(part 1 of 2)
# Autodesk Inventor assembly: PCB_v3.6
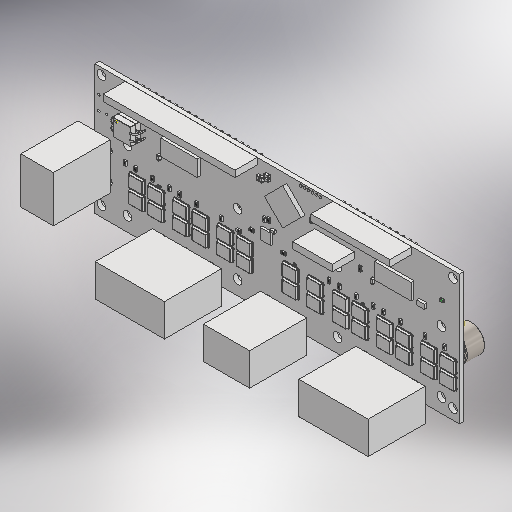
[picture p0: Inventor's stored thumbnail of the model, 512x512]
Saved by Autodesk Inventor 2025.2 (Build 292293000, 293)
## iProperties
Created: 2025-07-11
Part Number: PCB_v3.6
Description: STEP AP242
Document SubType Name: Assembly
Designer: 8326d
Title: 6870d66e9910ab7169fda94c
Sending System: ONSHAPE BY PTC INC, 1.200
Preprocessor: ST-DEVELOPER v20
## Documents named in this file (608)
- C:\Users\8326d\Downloads\PCB_v3.6\PCB_v3.6\PCB_v3.6.iam
- C:\Users\8326d\Downloads\PCB_v3.6\PCB_v3.6\Open CASCADE STEP translator 6.8 1.1.1.ipt
- C:\Users\8326d\Downloads\PCB_v3.6\PCB_v3.6\CAPC3216X175N_-_1206_(3216_metric).ipt
- C:\Users\8326d\Downloads\PCB_v3.6\PCB_v3.6\RES_0603_(1608_metric).ipt
- C:\Users\8326d\Downloads\PCB_v3.6\PCB_v3.6\Extruded.ipt
- C:\Users\8326d\Downloads\PCB_v3.6\PCB_v3.6\Extruded_1.ipt
- C:\Users\8326d\Downloads\PCB_v3.6\PCB_v3.6\Extruded_2.ipt
- C:\Users\8326d\Downloads\PCB_v3.6\PCB_v3.6\CAPC3216X175N_-_1206_(3216_metric)_1.ipt
- C:\Users\8326d\Downloads\PCB_v3.6\PCB_v3.6\RES_0603_(1608_metric)_1.ipt
- C:\Users\8326d\Downloads\PCB_v3.6\PCB_v3.6\RES_0603_(1608_metric)_2.ipt
- C:\Users\8326d\Downloads\PCB_v3.6\PCB_v3.6\RES_0603_(1608_metric)_3.ipt
- C:\Users\8326d\Downloads\PCB_v3.6\PCB_v3.6\RES_0603_(1608_metric)_4.ipt
- C:\Users\8326d\Downloads\PCB_v3.6\PCB_v3.6\Extruded_3.ipt
- C:\Users\8326d\Downloads\PCB_v3.6\PCB_v3.6\Extruded_1_1.ipt
- C:\Users\8326d\Downloads\PCB_v3.6\PCB_v3.6\Extruded_4.ipt
- C:\Users\8326d\Downloads\PCB_v3.6\PCB_v3.6\Extruded_2_1.ipt
- C:\Users\8326d\Downloads\PCB_v3.6\PCB_v3.6\Extruded_3_1.ipt
- C:\Users\8326d\Downloads\PCB_v3.6\PCB_v3.6\Extruded_1_2.ipt
- C:\Users\8326d\Downloads\PCB_v3.6\PCB_v3.6\Extruded_2_2.ipt
- C:\Users\8326d\Downloads\PCB_v3.6\PCB_v3.6\Extruded_3_2.ipt
- C:\Users\8326d\Downloads\PCB_v3.6\PCB_v3.6\Extruded_1_3.ipt
- C:\Users\8326d\Downloads\PCB_v3.6\PCB_v3.6\Extruded_4_1.ipt
- C:\Users\8326d\Downloads\PCB_v3.6\PCB_v3.6\Extruded_5.ipt
- C:\Users\8326d\Downloads\PCB_v3.6\PCB_v3.6\Extruded_2_3.ipt
- C:\Users\8326d\Downloads\PCB_v3.6\PCB_v3.6\Open_CASCADE_STEP_translator_6.8_2.1.ipt
- C:\Users\8326d\Downloads\PCB_v3.6\PCB_v3.6\Open_CASCADE_STEP_translator_6.8_2.2.1.ipt
- C:\Users\8326d\Downloads\PCB_v3.6\PCB_v3.6\Leader.ipt
- C:\Users\8326d\Downloads\PCB_v3.6\PCB_v3.6\Leader_1.ipt
- C:\Users\8326d\Downloads\PCB_v3.6\PCB_v3.6\Leader_2.ipt
- C:\Users\8326d\Downloads\PCB_v3.6\PCB_v3.6\Leader_3.ipt
- C:\Users\8326d\Downloads\PCB_v3.6\PCB_v3.6\Extruded_4_2.ipt
- C:\Users\8326d\Downloads\PCB_v3.6\PCB_v3.6\Extruded_5_1.ipt
- C:\Users\8326d\Downloads\PCB_v3.6\PCB_v3.6\Extruded_2_4.ipt
- C:\Users\8326d\Downloads\PCB_v3.6\PCB_v3.6\Extruded_6.ipt
- C:\Users\8326d\Downloads\PCB_v3.6\PCB_v3.6\Extruded_7.ipt
- C:\Users\8326d\Downloads\PCB_v3.6\PCB_v3.6\Extruded_1_4.ipt
- C:\Users\8326d\Downloads\PCB_v3.6\PCB_v3.6\SOT23-5.ipt
- C:\Users\8326d\Downloads\PCB_v3.6\PCB_v3.6\Extruded_6_1.ipt
- C:\Users\8326d\Downloads\PCB_v3.6\PCB_v3.6\Extruded_7_1.ipt
- C:\Users\8326d\Downloads\PCB_v3.6\PCB_v3.6\Extruded_3_3.ipt
- C:\Users\8326d\Downloads\PCB_v3.6\PCB_v3.6\RES_0402_(1005_metric).ipt
- C:\Users\8326d\Downloads\PCB_v3.6\PCB_v3.6\RES_0402_(1005_metric)_1.ipt
- C:\Users\8326d\Downloads\PCB_v3.6\PCB_v3.6\RES_0402_(1005_metric)_2.ipt
- C:\Users\8326d\Downloads\PCB_v3.6\PCB_v3.6\RES_0603_(1608_metric)_5.ipt
- C:\Users\8326d\Downloads\PCB_v3.6\PCB_v3.6\RES_0603_(1608_metric)_6.ipt
- C:\Users\8326d\Downloads\PCB_v3.6\PCB_v3.6\RES_0603_(1608_metric)_7.ipt
- C:\Users\8326d\Downloads\PCB_v3.6\PCB_v3.6\RES_0603_(1608_metric)_8.ipt
- C:\Users\8326d\Downloads\PCB_v3.6\PCB_v3.6\Extruded_3_4.ipt
- C:\Users\8326d\Downloads\PCB_v3.6\PCB_v3.6\Extruded_6_2.ipt
- C:\Users\8326d\Downloads\PCB_v3.6\PCB_v3.6\Extruded_7_2.ipt
- C:\Users\8326d\Downloads\PCB_v3.6\PCB_v3.6\Extruded_4_3.ipt
- C:\Users\8326d\Downloads\PCB_v3.6\PCB_v3.6\Extruded_8.ipt
- C:\Users\8326d\Downloads\PCB_v3.6\PCB_v3.6\Extruded_9.ipt
- C:\Users\8326d\Downloads\PCB_v3.6\PCB_v3.6\Extruded_4_4.ipt
- C:\Users\8326d\Downloads\PCB_v3.6\PCB_v3.6\Extruded_8_1.ipt
- C:\Users\8326d\Downloads\PCB_v3.6\PCB_v3.6\Extruded_9_1.ipt
- C:\Users\8326d\Downloads\PCB_v3.6\PCB_v3.6\Extruded_5_2.ipt
- C:\Users\8326d\Downloads\PCB_v3.6\PCB_v3.6\Extruded_10.ipt
- C:\Users\8326d\Downloads\PCB_v3.6\PCB_v3.6\Extruded_11.ipt
- C:\Users\8326d\Downloads\PCB_v3.6\PCB_v3.6\RES_0603_(1608_metric)_9.ipt
- C:\Users\8326d\Downloads\PCB_v3.6\PCB_v3.6\RES_0603_(1608_metric)_10.ipt
- C:\Users\8326d\Downloads\PCB_v3.6\PCB_v3.6\Extruded_12.ipt
- C:\Users\8326d\Downloads\PCB_v3.6\PCB_v3.6\Extruded_13.ipt
- C:\Users\8326d\Downloads\PCB_v3.6\PCB_v3.6\Extruded_14.ipt
- C:\Users\8326d\Downloads\PCB_v3.6\PCB_v3.6\Extruded_15.ipt
- C:\Users\8326d\Downloads\PCB_v3.6\PCB_v3.6\Extruded_16.ipt
- C:\Users\8326d\Downloads\PCB_v3.6\PCB_v3.6\SOT223-4.ipt
- C:\Users\8326d\Downloads\PCB_v3.6\PCB_v3.6\RES_0603_(1608_metric)_11.ipt
- C:\Users\8326d\Downloads\PCB_v3.6\PCB_v3.6\RES_0603_(1608_metric)_12.ipt
- C:\Users\8326d\Downloads\PCB_v3.6\PCB_v3.6\RES_0603_(1608_metric)_13.ipt
- C:\Users\8326d\Downloads\PCB_v3.6\PCB_v3.6\RES_0603_(1608_metric)_14.ipt
- C:\Users\8326d\Downloads\PCB_v3.6\PCB_v3.6\Extruded_17.ipt
- C:\Users\8326d\Downloads\PCB_v3.6\PCB_v3.6\Extruded_18.ipt
- C:\Users\8326d\Downloads\PCB_v3.6\PCB_v3.6\Extruded_1_5.ipt
- C:\Users\8326d\Downloads\PCB_v3.6\PCB_v3.6\Extruded_2_5.ipt
- C:\Users\8326d\Downloads\PCB_v3.6\PCB_v3.6\Extruded_1_6.ipt
- C:\Users\8326d\Downloads\PCB_v3.6\PCB_v3.6\Extruded_3_5.ipt
- C:\Users\8326d\Downloads\PCB_v3.6\PCB_v3.6\RES_0603_(1608_metric)_15.ipt
- C:\Users\8326d\Downloads\PCB_v3.6\PCB_v3.6\RES_0603_(1608_metric)_16.ipt
- C:\Users\8326d\Downloads\PCB_v3.6\PCB_v3.6\RES_0603_(1608_metric)_17.ipt
- C:\Users\8326d\Downloads\PCB_v3.6\PCB_v3.6\RES_0603_(1608_metric)_18.ipt
- C:\Users\8326d\Downloads\PCB_v3.6\PCB_v3.6\RES_0603_(1608_metric)_19.ipt
- C:\Users\8326d\Downloads\PCB_v3.6\PCB_v3.6\RES_0603_(1608_metric)_20.ipt
- C:\Users\8326d\Downloads\PCB_v3.6\PCB_v3.6\RES_0603_(1608_metric)_21.ipt
- C:\Users\8326d\Downloads\PCB_v3.6\PCB_v3.6\RES_0603_(1608_metric)_22.ipt
- C:\Users\8326d\Downloads\PCB_v3.6\PCB_v3.6\RES_0603_(1608_metric)_23.ipt
- C:\Users\8326d\Downloads\PCB_v3.6\PCB_v3.6\RES_0603_(1608_metric)_24.ipt
- C:\Users\8326d\Downloads\PCB_v3.6\PCB_v3.6\RES_0603_(1608_metric)_25.ipt
- C:\Users\8326d\Downloads\PCB_v3.6\PCB_v3.6\RES_0603_(1608_metric)_26.ipt
- C:\Users\8326d\Downloads\PCB_v3.6\PCB_v3.6\RES_0603_(1608_metric)_27.ipt
- C:\Users\8326d\Downloads\PCB_v3.6\PCB_v3.6\RES_0603_(1608_metric)_28.ipt
- C:\Users\8326d\Downloads\PCB_v3.6\PCB_v3.6\RES_0603_(1608_metric)_29.ipt
- C:\Users\8326d\Downloads\PCB_v3.6\PCB_v3.6\RES_0603_(1608_metric)_30.ipt
- C:\Users\8326d\Downloads\PCB_v3.6\PCB_v3.6\RES_0603_(1608_metric)_31.ipt
- C:\Users\8326d\Downloads\PCB_v3.6\PCB_v3.6\RES_0603_(1608_metric)_32.ipt
- C:\Users\8326d\Downloads\PCB_v3.6\PCB_v3.6\RES_0603_(1608_metric)_33.ipt
- C:\Users\8326d\Downloads\PCB_v3.6\PCB_v3.6\RES_0603_(1608_metric)_34.ipt
- C:\Users\8326d\Downloads\PCB_v3.6\PCB_v3.6\RES_0603_(1608_metric)_35.ipt
- C:\Users\8326d\Downloads\PCB_v3.6\PCB_v3.6\RES_0603_(1608_metric)_36.ipt
- C:\Users\8326d\Downloads\PCB_v3.6\PCB_v3.6\User_Library-DFN5x6_SO8FL_Extruded.ipt
- C:\Users\8326d\Downloads\PCB_v3.6\PCB_v3.6\User_Library-DFN5x6_SO8FL_Extruded_2.ipt
- C:\Users\8326d\Downloads\PCB_v3.6\PCB_v3.6\User_Library-DFN5x6_SO8FL_Extruded_2_1.ipt
- C:\Users\8326d\Downloads\PCB_v3.6\PCB_v3.6\User_Library-DFN5x6_SO8FL_Extruded_1.ipt
- C:\Users\8326d\Downloads\PCB_v3.6\PCB_v3.6\User_Library-DFN5x6_SO8FL_Cylinder.ipt
- C:\Users\8326d\Downloads\PCB_v3.6\PCB_v3.6\User_Library-DFN5x6_SO8FL_Extruded_3.ipt
- C:\Users\8326d\Downloads\PCB_v3.6\PCB_v3.6\User_Library-DFN5x6_SO8FL_Extruded_4.ipt
- C:\Users\8326d\Downloads\PCB_v3.6\PCB_v3.6\User_Library-DFN5x6_SO8FL_Extruded_5.ipt
- C:\Users\8326d\Downloads\PCB_v3.6\PCB_v3.6\User_Library-DFN5x6_SO8FL_Extruded_5_1.ipt
- C:\Users\8326d\Downloads\PCB_v3.6\PCB_v3.6\User_Library-DFN5x6_SO8FL_Extruded_5_2.ipt
- C:\Users\8326d\Downloads\PCB_v3.6\PCB_v3.6\User_Library-DFN5x6_SO8FL_Extruded_5_3.ipt
- C:\Users\8326d\Downloads\PCB_v3.6\PCB_v3.6\User_Library-DFN5x6_SO8FL_Extruded_6.ipt
- C:\Users\8326d\Downloads\PCB_v3.6\PCB_v3.6\User_Library-DFN5x6_SO8FL_Extruded_2_2.ipt
- C:\Users\8326d\Downloads\PCB_v3.6\PCB_v3.6\User_Library-DFN5x6_SO8FL_Extruded_2_2_1.ipt
- C:\Users\8326d\Downloads\PCB_v3.6\PCB_v3.6\User_Library-DFN5x6_SO8FL_Extruded_2_3.ipt
- C:\Users\8326d\Downloads\PCB_v3.6\PCB_v3.6\User_Library-DFN5x6_SO8FL_Extruded_3_1.ipt
- C:\Users\8326d\Downloads\PCB_v3.6\PCB_v3.6\User_Library-DFN5x6_SO8FL_Cylinder_1.ipt
- C:\Users\8326d\Downloads\PCB_v3.6\PCB_v3.6\User_Library-DFN5x6_SO8FL_Extruded_3_1_1.ipt
- C:\Users\8326d\Downloads\PCB_v3.6\PCB_v3.6\User_Library-DFN5x6_SO8FL_Extruded_4_1.ipt
- C:\Users\8326d\Downloads\PCB_v3.6\PCB_v3.6\User_Library-DFN5x6_SO8FL_Extruded_5_4.ipt
- C:\Users\8326d\Downloads\PCB_v3.6\PCB_v3.6\User_Library-DFN5x6_SO8FL_Extruded_5_5.ipt
- C:\Users\8326d\Downloads\PCB_v3.6\PCB_v3.6\User_Library-DFN5x6_SO8FL_Extruded_5_6.ipt
- C:\Users\8326d\Downloads\PCB_v3.6\PCB_v3.6\User_Library-DFN5x6_SO8FL_Extruded_5_7.ipt
- C:\Users\8326d\Downloads\PCB_v3.6\PCB_v3.6\User_Library-DFN5x6_SO8FL_Extruded_6_1.ipt
- C:\Users\8326d\Downloads\PCB_v3.6\PCB_v3.6\User_Library-DFN5x6_SO8FL_Extruded_4_2.ipt
- C:\Users\8326d\Downloads\PCB_v3.6\PCB_v3.6\User_Library-DFN5x6_SO8FL_Extruded_2_4.ipt
- C:\Users\8326d\Downloads\PCB_v3.6\PCB_v3.6\User_Library-DFN5x6_SO8FL_Extruded_2_5.ipt
- C:\Users\8326d\Downloads\PCB_v3.6\PCB_v3.6\User_Library-DFN5x6_SO8FL_Extruded_5_8.ipt
- C:\Users\8326d\Downloads\PCB_v3.6\PCB_v3.6\User_Library-DFN5x6_SO8FL_Cylinder_2.ipt
- C:\Users\8326d\Downloads\PCB_v3.6\PCB_v3.6\User_Library-DFN5x6_SO8FL_Extruded_3_2.ipt
- C:\Users\8326d\Downloads\PCB_v3.6\PCB_v3.6\User_Library-DFN5x6_SO8FL_Extruded_4_2_1.ipt
- C:\Users\8326d\Downloads\PCB_v3.6\PCB_v3.6\User_Library-DFN5x6_SO8FL_Extruded_5_8_1.ipt
- C:\Users\8326d\Downloads\PCB_v3.6\PCB_v3.6\User_Library-DFN5x6_SO8FL_Extruded_5_9.ipt
- C:\Users\8326d\Downloads\PCB_v3.6\PCB_v3.6\User_Library-DFN5x6_SO8FL_Extruded_5_10.ipt
- C:\Users\8326d\Downloads\PCB_v3.6\PCB_v3.6\User_Library-DFN5x6_SO8FL_Extruded_5_11.ipt
- C:\Users\8326d\Downloads\PCB_v3.6\PCB_v3.6\User_Library-DFN5x6_SO8FL_Extruded_6_2.ipt
- C:\Users\8326d\Downloads\PCB_v3.6\PCB_v3.6\User_Library-DFN5x6_SO8FL_Extruded_6_3.ipt
- C:\Users\8326d\Downloads\PCB_v3.6\PCB_v3.6\User_Library-DFN5x6_SO8FL_Extruded_2_6.ipt
- C:\Users\8326d\Downloads\PCB_v3.6\PCB_v3.6\User_Library-DFN5x6_SO8FL_Extruded_2_7.ipt
- C:\Users\8326d\Downloads\PCB_v3.6\PCB_v3.6\User_Library-DFN5x6_SO8FL_Extruded_7.ipt
- C:\Users\8326d\Downloads\PCB_v3.6\PCB_v3.6\User_Library-DFN5x6_SO8FL_Cylinder_3.ipt
- C:\Users\8326d\Downloads\PCB_v3.6\PCB_v3.6\User_Library-DFN5x6_SO8FL_Extruded_3_3.ipt
- C:\Users\8326d\Downloads\PCB_v3.6\PCB_v3.6\User_Library-DFN5x6_SO8FL_Extruded_4_3.ipt
- C:\Users\8326d\Downloads\PCB_v3.6\PCB_v3.6\User_Library-DFN5x6_SO8FL_Extruded_5_12.ipt
- C:\Users\8326d\Downloads\PCB_v3.6\PCB_v3.6\User_Library-DFN5x6_SO8FL_Extruded_5_13.ipt
- C:\Users\8326d\Downloads\PCB_v3.6\PCB_v3.6\User_Library-DFN5x6_SO8FL_Extruded_5_14.ipt
- C:\Users\8326d\Downloads\PCB_v3.6\PCB_v3.6\User_Library-DFN5x6_SO8FL_Extruded_5_15.ipt
- C:\Users\8326d\Downloads\PCB_v3.6\PCB_v3.6\User_Library-DFN5x6_SO8FL_Extruded_6_3_1.ipt
- C:\Users\8326d\Downloads\PCB_v3.6\PCB_v3.6\User_Library-DFN5x6_SO8FL_Extruded_8.ipt
- C:\Users\8326d\Downloads\PCB_v3.6\PCB_v3.6\User_Library-DFN5x6_SO8FL_Extruded_2_8.ipt
- C:\Users\8326d\Downloads\PCB_v3.6\PCB_v3.6\User_Library-DFN5x6_SO8FL_Extruded_2_9.ipt
- C:\Users\8326d\Downloads\PCB_v3.6\PCB_v3.6\User_Library-DFN5x6_SO8FL_Extruded_9.ipt
- C:\Users\8326d\Downloads\PCB_v3.6\PCB_v3.6\User_Library-DFN5x6_SO8FL_Cylinder_4.ipt
- C:\Users\8326d\Downloads\PCB_v3.6\PCB_v3.6\User_Library-DFN5x6_SO8FL_Extruded_3_4.ipt
- C:\Users\8326d\Downloads\PCB_v3.6\PCB_v3.6\User_Library-DFN5x6_SO8FL_Extruded_4_4.ipt
- C:\Users\8326d\Downloads\PCB_v3.6\PCB_v3.6\User_Library-DFN5x6_SO8FL_Extruded_5_16.ipt
- C:\Users\8326d\Downloads\PCB_v3.6\PCB_v3.6\User_Library-DFN5x6_SO8FL_Extruded_5_17.ipt
- C:\Users\8326d\Downloads\PCB_v3.6\PCB_v3.6\User_Library-DFN5x6_SO8FL_Extruded_5_18.ipt
- C:\Users\8326d\Downloads\PCB_v3.6\PCB_v3.6\User_Library-DFN5x6_SO8FL_Extruded_5_19.ipt
- C:\Users\8326d\Downloads\PCB_v3.6\PCB_v3.6\User_Library-DFN5x6_SO8FL_Extruded_6_4.ipt
- C:\Users\8326d\Downloads\PCB_v3.6\PCB_v3.6\User_Library-DFN5x6_SO8FL_Extruded_10.ipt
- C:\Users\8326d\Downloads\PCB_v3.6\PCB_v3.6\User_Library-DFN5x6_SO8FL_Extruded_2_10.ipt
- C:\Users\8326d\Downloads\PCB_v3.6\PCB_v3.6\User_Library-DFN5x6_SO8FL_Extruded_2_11.ipt
- C:\Users\8326d\Downloads\PCB_v3.6\PCB_v3.6\User_Library-DFN5x6_SO8FL_Extruded_11.ipt
- C:\Users\8326d\Downloads\PCB_v3.6\PCB_v3.6\User_Library-DFN5x6_SO8FL_Cylinder_5.ipt
- C:\Users\8326d\Downloads\PCB_v3.6\PCB_v3.6\User_Library-DFN5x6_SO8FL_Extruded_3_5.ipt
- C:\Users\8326d\Downloads\PCB_v3.6\PCB_v3.6\User_Library-DFN5x6_SO8FL_Extruded_4_5.ipt
- C:\Users\8326d\Downloads\PCB_v3.6\PCB_v3.6\User_Library-DFN5x6_SO8FL_Extruded_5_20.ipt
- C:\Users\8326d\Downloads\PCB_v3.6\PCB_v3.6\User_Library-DFN5x6_SO8FL_Extruded_5_21.ipt
- C:\Users\8326d\Downloads\PCB_v3.6\PCB_v3.6\User_Library-DFN5x6_SO8FL_Extruded_5_22.ipt
- C:\Users\8326d\Downloads\PCB_v3.6\PCB_v3.6\User_Library-DFN5x6_SO8FL_Extruded_5_23.ipt
- C:\Users\8326d\Downloads\PCB_v3.6\PCB_v3.6\User_Library-DFN5x6_SO8FL_Extruded_6_5.ipt
- C:\Users\8326d\Downloads\PCB_v3.6\PCB_v3.6\User_Library-DFN5x6_SO8FL_Extruded_12.ipt
- C:\Users\8326d\Downloads\PCB_v3.6\PCB_v3.6\User_Library-DFN5x6_SO8FL_Extruded_2_12.ipt
- C:\Users\8326d\Downloads\PCB_v3.6\PCB_v3.6\User_Library-DFN5x6_SO8FL_Extruded_2_13.ipt
- C:\Users\8326d\Downloads\PCB_v3.6\PCB_v3.6\User_Library-DFN5x6_SO8FL_Extruded_13.ipt
- C:\Users\8326d\Downloads\PCB_v3.6\PCB_v3.6\User_Library-DFN5x6_SO8FL_Cylinder_6.ipt
- C:\Users\8326d\Downloads\PCB_v3.6\PCB_v3.6\User_Library-DFN5x6_SO8FL_Extruded_3_6.ipt
- C:\Users\8326d\Downloads\PCB_v3.6\PCB_v3.6\User_Library-DFN5x6_SO8FL_Extruded_4_6.ipt
- C:\Users\8326d\Downloads\PCB_v3.6\PCB_v3.6\User_Library-DFN5x6_SO8FL_Extruded_5_24.ipt
- C:\Users\8326d\Downloads\PCB_v3.6\PCB_v3.6\User_Library-DFN5x6_SO8FL_Extruded_5_25.ipt
- C:\Users\8326d\Downloads\PCB_v3.6\PCB_v3.6\User_Library-DFN5x6_SO8FL_Extruded_5_26.ipt
- C:\Users\8326d\Downloads\PCB_v3.6\PCB_v3.6\User_Library-DFN5x6_SO8FL_Extruded_5_27.ipt
- C:\Users\8326d\Downloads\PCB_v3.6\PCB_v3.6\User_Library-DFN5x6_SO8FL_Extruded_6_6.ipt
- C:\Users\8326d\Downloads\PCB_v3.6\PCB_v3.6\User_Library-DFN5x6_SO8FL_Extruded_14.ipt
- C:\Users\8326d\Downloads\PCB_v3.6\PCB_v3.6\User_Library-DFN5x6_SO8FL_Extruded_2_14.ipt
- C:\Users\8326d\Downloads\PCB_v3.6\PCB_v3.6\User_Library-DFN5x6_SO8FL_Extruded_2_15.ipt
- C:\Users\8326d\Downloads\PCB_v3.6\PCB_v3.6\User_Library-DFN5x6_SO8FL_Extruded_15.ipt
- C:\Users\8326d\Downloads\PCB_v3.6\PCB_v3.6\User_Library-DFN5x6_SO8FL_Cylinder_7.ipt
- C:\Users\8326d\Downloads\PCB_v3.6\PCB_v3.6\User_Library-DFN5x6_SO8FL_Extruded_3_7.ipt
- C:\Users\8326d\Downloads\PCB_v3.6\PCB_v3.6\User_Library-DFN5x6_SO8FL_Extruded_4_7.ipt
- C:\Users\8326d\Downloads\PCB_v3.6\PCB_v3.6\User_Library-DFN5x6_SO8FL_Extruded_5_28.ipt
- C:\Users\8326d\Downloads\PCB_v3.6\PCB_v3.6\User_Library-DFN5x6_SO8FL_Extruded_5_29.ipt
- C:\Users\8326d\Downloads\PCB_v3.6\PCB_v3.6\User_Library-DFN5x6_SO8FL_Extruded_5_30.ipt
- C:\Users\8326d\Downloads\PCB_v3.6\PCB_v3.6\User_Library-DFN5x6_SO8FL_Extruded_5_31.ipt
- C:\Users\8326d\Downloads\PCB_v3.6\PCB_v3.6\User_Library-DFN5x6_SO8FL_Extruded_6_7.ipt
- C:\Users\8326d\Downloads\PCB_v3.6\PCB_v3.6\User_Library-DFN5x6_SO8FL_Extruded_16.ipt
- C:\Users\8326d\Downloads\PCB_v3.6\PCB_v3.6\User_Library-DFN5x6_SO8FL_Extruded_2_16.ipt
- C:\Users\8326d\Downloads\PCB_v3.6\PCB_v3.6\User_Library-DFN5x6_SO8FL_Extruded_2_17.ipt
- C:\Users\8326d\Downloads\PCB_v3.6\PCB_v3.6\User_Library-DFN5x6_SO8FL_Extruded_17.ipt
- C:\Users\8326d\Downloads\PCB_v3.6\PCB_v3.6\User_Library-DFN5x6_SO8FL_Cylinder_8.ipt
- C:\Users\8326d\Downloads\PCB_v3.6\PCB_v3.6\User_Library-DFN5x6_SO8FL_Extruded_3_8.ipt
- C:\Users\8326d\Downloads\PCB_v3.6\PCB_v3.6\User_Library-DFN5x6_SO8FL_Extruded_4_8.ipt
- C:\Users\8326d\Downloads\PCB_v3.6\PCB_v3.6\User_Library-DFN5x6_SO8FL_Extruded_5_32.ipt
- C:\Users\8326d\Downloads\PCB_v3.6\PCB_v3.6\User_Library-DFN5x6_SO8FL_Extruded_5_33.ipt
- C:\Users\8326d\Downloads\PCB_v3.6\PCB_v3.6\User_Library-DFN5x6_SO8FL_Extruded_5_34.ipt
- C:\Users\8326d\Downloads\PCB_v3.6\PCB_v3.6\User_Library-DFN5x6_SO8FL_Extruded_5_35.ipt
- C:\Users\8326d\Downloads\PCB_v3.6\PCB_v3.6\User_Library-DFN5x6_SO8FL_Extruded_6_8.ipt
- C:\Users\8326d\Downloads\PCB_v3.6\PCB_v3.6\User_Library-DFN5x6_SO8FL_Extruded_18.ipt
- C:\Users\8326d\Downloads\PCB_v3.6\PCB_v3.6\User_Library-DFN5x6_SO8FL_Extruded_2_18.ipt
- C:\Users\8326d\Downloads\PCB_v3.6\PCB_v3.6\User_Library-DFN5x6_SO8FL_Extruded_2_19.ipt
- C:\Users\8326d\Downloads\PCB_v3.6\PCB_v3.6\User_Library-DFN5x6_SO8FL_Extruded_19.ipt
- C:\Users\8326d\Downloads\PCB_v3.6\PCB_v3.6\User_Library-DFN5x6_SO8FL_Cylinder_9.ipt
- C:\Users\8326d\Downloads\PCB_v3.6\PCB_v3.6\User_Library-DFN5x6_SO8FL_Extruded_3_9.ipt
- C:\Users\8326d\Downloads\PCB_v3.6\PCB_v3.6\User_Library-DFN5x6_SO8FL_Extruded_4_9.ipt
- C:\Users\8326d\Downloads\PCB_v3.6\PCB_v3.6\User_Library-DFN5x6_SO8FL_Extruded_5_36.ipt
- C:\Users\8326d\Downloads\PCB_v3.6\PCB_v3.6\User_Library-DFN5x6_SO8FL_Extruded_5_37.ipt
- C:\Users\8326d\Downloads\PCB_v3.6\PCB_v3.6\User_Library-DFN5x6_SO8FL_Extruded_5_38.ipt
- C:\Users\8326d\Downloads\PCB_v3.6\PCB_v3.6\User_Library-DFN5x6_SO8FL_Extruded_5_39.ipt
- C:\Users\8326d\Downloads\PCB_v3.6\PCB_v3.6\User_Library-DFN5x6_SO8FL_Extruded_6_9.ipt
- C:\Users\8326d\Downloads\PCB_v3.6\PCB_v3.6\User_Library-DFN5x6_SO8FL_Extruded_20.ipt
- C:\Users\8326d\Downloads\PCB_v3.6\PCB_v3.6\User_Library-DFN5x6_SO8FL_Extruded_2_20.ipt
- C:\Users\8326d\Downloads\PCB_v3.6\PCB_v3.6\User_Library-DFN5x6_SO8FL_Extruded_2_21.ipt
- C:\Users\8326d\Downloads\PCB_v3.6\PCB_v3.6\User_Library-DFN5x6_SO8FL_Extruded_21.ipt
- C:\Users\8326d\Downloads\PCB_v3.6\PCB_v3.6\User_Library-DFN5x6_SO8FL_Cylinder_10.ipt
- C:\Users\8326d\Downloads\PCB_v3.6\PCB_v3.6\User_Library-DFN5x6_SO8FL_Extruded_3_10.ipt
- C:\Users\8326d\Downloads\PCB_v3.6\PCB_v3.6\User_Library-DFN5x6_SO8FL_Extruded_4_10.ipt
- C:\Users\8326d\Downloads\PCB_v3.6\PCB_v3.6\User_Library-DFN5x6_SO8FL_Extruded_5_40.ipt
- C:\Users\8326d\Downloads\PCB_v3.6\PCB_v3.6\User_Library-DFN5x6_SO8FL_Extruded_5_41.ipt
- C:\Users\8326d\Downloads\PCB_v3.6\PCB_v3.6\User_Library-DFN5x6_SO8FL_Extruded_5_42.ipt
- C:\Users\8326d\Downloads\PCB_v3.6\PCB_v3.6\User_Library-DFN5x6_SO8FL_Extruded_5_43.ipt
- C:\Users\8326d\Downloads\PCB_v3.6\PCB_v3.6\User_Library-DFN5x6_SO8FL_Extruded_6_10.ipt
- C:\Users\8326d\Downloads\PCB_v3.6\PCB_v3.6\User_Library-DFN5x6_SO8FL_Extruded_22.ipt
- C:\Users\8326d\Downloads\PCB_v3.6\PCB_v3.6\User_Library-DFN5x6_SO8FL_Extruded_2_22.ipt
- C:\Users\8326d\Downloads\PCB_v3.6\PCB_v3.6\User_Library-DFN5x6_SO8FL_Extruded_2_23.ipt
- C:\Users\8326d\Downloads\PCB_v3.6\PCB_v3.6\User_Library-DFN5x6_SO8FL_Extruded_23.ipt
- C:\Users\8326d\Downloads\PCB_v3.6\PCB_v3.6\User_Library-DFN5x6_SO8FL_Cylinder_11.ipt
- C:\Users\8326d\Downloads\PCB_v3.6\PCB_v3.6\User_Library-DFN5x6_SO8FL_Extruded_3_11.ipt
- C:\Users\8326d\Downloads\PCB_v3.6\PCB_v3.6\User_Library-DFN5x6_SO8FL_Extruded_4_11.ipt
- C:\Users\8326d\Downloads\PCB_v3.6\PCB_v3.6\User_Library-DFN5x6_SO8FL_Extruded_5_44.ipt
- C:\Users\8326d\Downloads\PCB_v3.6\PCB_v3.6\User_Library-DFN5x6_SO8FL_Extruded_5_45.ipt
- C:\Users\8326d\Downloads\PCB_v3.6\PCB_v3.6\User_Library-DFN5x6_SO8FL_Extruded_5_46.ipt
- C:\Users\8326d\Downloads\PCB_v3.6\PCB_v3.6\User_Library-DFN5x6_SO8FL_Extruded_5_47.ipt
- C:\Users\8326d\Downloads\PCB_v3.6\PCB_v3.6\User_Library-DFN5x6_SO8FL_Extruded_6_11.ipt
- C:\Users\8326d\Downloads\PCB_v3.6\PCB_v3.6\User_Library-DFN5x6_SO8FL_Extruded_24.ipt
- C:\Users\8326d\Downloads\PCB_v3.6\PCB_v3.6\User_Library-DFN5x6_SO8FL_Extruded_2_24.ipt
- C:\Users\8326d\Downloads\PCB_v3.6\PCB_v3.6\User_Library-DFN5x6_SO8FL_Extruded_2_25.ipt
- C:\Users\8326d\Downloads\PCB_v3.6\PCB_v3.6\User_Library-DFN5x6_SO8FL_Extruded_25.ipt
- C:\Users\8326d\Downloads\PCB_v3.6\PCB_v3.6\User_Library-DFN5x6_SO8FL_Cylinder_12.ipt
- C:\Users\8326d\Downloads\PCB_v3.6\PCB_v3.6\User_Library-DFN5x6_SO8FL_Extruded_3_12.ipt
- C:\Users\8326d\Downloads\PCB_v3.6\PCB_v3.6\User_Library-DFN5x6_SO8FL_Extruded_4_12.ipt
- C:\Users\8326d\Downloads\PCB_v3.6\PCB_v3.6\User_Library-DFN5x6_SO8FL_Extruded_5_48.ipt
- C:\Users\8326d\Downloads\PCB_v3.6\PCB_v3.6\User_Library-DFN5x6_SO8FL_Extruded_5_49.ipt
- C:\Users\8326d\Downloads\PCB_v3.6\PCB_v3.6\User_Library-DFN5x6_SO8FL_Extruded_5_50.ipt
- C:\Users\8326d\Downloads\PCB_v3.6\PCB_v3.6\User_Library-DFN5x6_SO8FL_Extruded_5_51.ipt
- C:\Users\8326d\Downloads\PCB_v3.6\PCB_v3.6\User_Library-DFN5x6_SO8FL_Extruded_6_12.ipt
- C:\Users\8326d\Downloads\PCB_v3.6\PCB_v3.6\User_Library-DFN5x6_SO8FL_Extruded_26.ipt
- C:\Users\8326d\Downloads\PCB_v3.6\PCB_v3.6\User_Library-DFN5x6_SO8FL_Extruded_2_26.ipt
- C:\Users\8326d\Downloads\PCB_v3.6\PCB_v3.6\User_Library-DFN5x6_SO8FL_Extruded_2_27.ipt
- C:\Users\8326d\Downloads\PCB_v3.6\PCB_v3.6\User_Library-DFN5x6_SO8FL_Extruded_27.ipt
- C:\Users\8326d\Downloads\PCB_v3.6\PCB_v3.6\User_Library-DFN5x6_SO8FL_Cylinder_13.ipt
- C:\Users\8326d\Downloads\PCB_v3.6\PCB_v3.6\User_Library-DFN5x6_SO8FL_Extruded_3_13.ipt
- C:\Users\8326d\Downloads\PCB_v3.6\PCB_v3.6\User_Library-DFN5x6_SO8FL_Extruded_4_13.ipt
- C:\Users\8326d\Downloads\PCB_v3.6\PCB_v3.6\User_Library-DFN5x6_SO8FL_Extruded_5_52.ipt
- C:\Users\8326d\Downloads\PCB_v3.6\PCB_v3.6\User_Library-DFN5x6_SO8FL_Extruded_5_53.ipt
- C:\Users\8326d\Downloads\PCB_v3.6\PCB_v3.6\User_Library-DFN5x6_SO8FL_Extruded_5_54.ipt
- C:\Users\8326d\Downloads\PCB_v3.6\PCB_v3.6\User_Library-DFN5x6_SO8FL_Extruded_5_55.ipt
- C:\Users\8326d\Downloads\PCB_v3.6\PCB_v3.6\User_Library-DFN5x6_SO8FL_Extruded_6_13.ipt
- C:\Users\8326d\Downloads\PCB_v3.6\PCB_v3.6\User_Library-DFN5x6_SO8FL_Extruded_28.ipt
- C:\Users\8326d\Downloads\PCB_v3.6\PCB_v3.6\User_Library-DFN5x6_SO8FL_Extruded_2_28.ipt
- C:\Users\8326d\Downloads\PCB_v3.6\PCB_v3.6\User_Library-DFN5x6_SO8FL_Extruded_2_29.ipt
- C:\Users\8326d\Downloads\PCB_v3.6\PCB_v3.6\User_Library-DFN5x6_SO8FL_Extruded_29.ipt
- C:\Users\8326d\Downloads\PCB_v3.6\PCB_v3.6\User_Library-DFN5x6_SO8FL_Cylinder_14.ipt
- C:\Users\8326d\Downloads\PCB_v3.6\PCB_v3.6\User_Library-DFN5x6_SO8FL_Extruded_3_14.ipt
- C:\Users\8326d\Downloads\PCB_v3.6\PCB_v3.6\User_Library-DFN5x6_SO8FL_Extruded_4_14.ipt
- C:\Users\8326d\Downloads\PCB_v3.6\PCB_v3.6\User_Library-DFN5x6_SO8FL_Extruded_5_56.ipt
- C:\Users\8326d\Downloads\PCB_v3.6\PCB_v3.6\User_Library-DFN5x6_SO8FL_Extruded_5_57.ipt
- C:\Users\8326d\Downloads\PCB_v3.6\PCB_v3.6\User_Library-DFN5x6_SO8FL_Extruded_5_58.ipt
- C:\Users\8326d\Downloads\PCB_v3.6\PCB_v3.6\User_Library-DFN5x6_SO8FL_Extruded_5_59.ipt
- C:\Users\8326d\Downloads\PCB_v3.6\PCB_v3.6\User_Library-DFN5x6_SO8FL_Extruded_6_14.ipt
- C:\Users\8326d\Downloads\PCB_v3.6\PCB_v3.6\User_Library-DFN5x6_SO8FL_Extruded_30.ipt
- C:\Users\8326d\Downloads\PCB_v3.6\PCB_v3.6\User_Library-DFN5x6_SO8FL_Extruded_2_30.ipt
- C:\Users\8326d\Downloads\PCB_v3.6\PCB_v3.6\User_Library-DFN5x6_SO8FL_Extruded_2_31.ipt
- C:\Users\8326d\Downloads\PCB_v3.6\PCB_v3.6\User_Library-DFN5x6_SO8FL_Extruded_31.ipt
- C:\Users\8326d\Downloads\PCB_v3.6\PCB_v3.6\User_Library-DFN5x6_SO8FL_Cylinder_15.ipt
- C:\Users\8326d\Downloads\PCB_v3.6\PCB_v3.6\User_Library-DFN5x6_SO8FL_Extruded_3_15.ipt
- C:\Users\8326d\Downloads\PCB_v3.6\PCB_v3.6\User_Library-DFN5x6_SO8FL_Extruded_4_15.ipt
- C:\Users\8326d\Downloads\PCB_v3.6\PCB_v3.6\User_Library-DFN5x6_SO8FL_Extruded_5_60.ipt
- C:\Users\8326d\Downloads\PCB_v3.6\PCB_v3.6\User_Library-DFN5x6_SO8FL_Extruded_5_61.ipt
- C:\Users\8326d\Downloads\PCB_v3.6\PCB_v3.6\User_Library-DFN5x6_SO8FL_Extruded_5_62.ipt
- C:\Users\8326d\Downloads\PCB_v3.6\PCB_v3.6\User_Library-DFN5x6_SO8FL_Extruded_5_63.ipt
- C:\Users\8326d\Downloads\PCB_v3.6\PCB_v3.6\User_Library-DFN5x6_SO8FL_Extruded_6_15.ipt
- C:\Users\8326d\Downloads\PCB_v3.6\PCB_v3.6\Extruded_19.ipt
- C:\Users\8326d\Downloads\PCB_v3.6\PCB_v3.6\Extruded_20.ipt
- C:\Users\8326d\Downloads\PCB_v3.6\PCB_v3.6\Extruded_1_7.ipt
- C:\Users\8326d\Downloads\PCB_v3.6\PCB_v3.6\Extruded_21.ipt
- C:\Users\8326d\Downloads\PCB_v3.6\PCB_v3.6\Extruded_1_8.ipt
- C:\Users\8326d\Downloads\PCB_v3.6\PCB_v3.6\Extruded_5_3.ipt
- C:\Users\8326d\Downloads\PCB_v3.6\PCB_v3.6\Extruded_10_1.ipt
- C:\Users\8326d\Downloads\PCB_v3.6\PCB_v3.6\Extruded_11_1.ipt
- C:\Users\8326d\Downloads\PCB_v3.6\PCB_v3.6\Extruded_6_3.ipt
- C:\Users\8326d\Downloads\PCB_v3.6\PCB_v3.6\Extruded_12_1.ipt
- C:\Users\8326d\Downloads\PCB_v3.6\PCB_v3.6\Extruded_13_1.ipt
- C:\Users\8326d\Downloads\PCB_v3.6\PCB_v3.6\Extruded_6_4.ipt
- C:\Users\8326d\Downloads\PCB_v3.6\PCB_v3.6\Extruded_12_2.ipt
- C:\Users\8326d\Downloads\PCB_v3.6\PCB_v3.6\Extruded_13_2.ipt
- C:\Users\8326d\Downloads\PCB_v3.6\PCB_v3.6\Extruded_7_3.ipt
- C:\Users\8326d\Downloads\PCB_v3.6\PCB_v3.6\Extruded_14_1.ipt
- C:\Users\8326d\Downloads\PCB_v3.6\PCB_v3.6\Extruded_15_1.ipt
- C:\Users\8326d\Downloads\PCB_v3.6\PCB_v3.6\Extruded_8_2.ipt
- C:\Users\8326d\Downloads\PCB_v3.6\PCB_v3.6\Extruded_16_1.ipt
- C:\Users\8326d\Downloads\PCB_v3.6\PCB_v3.6\Extruded_17_1.ipt
- C:\Users\8326d\Downloads\PCB_v3.6\PCB_v3.6\CAPC3216X175N_-_1206_(3216_metric)_2.ipt
- C:\Users\8326d\Downloads\PCB_v3.6\PCB_v3.6\Extruded_9_2.ipt
- C:\Users\8326d\Downloads\PCB_v3.6\PCB_v3.6\Extruded_18_1.ipt
- C:\Users\8326d\Downloads\PCB_v3.6\PCB_v3.6\Extruded_19_1.ipt
- C:\Users\8326d\Downloads\PCB_v3.6\PCB_v3.6\Extruded_7_4.ipt
- C:\Users\8326d\Downloads\PCB_v3.6\PCB_v3.6\Extruded_14_2.ipt
- C:\Users\8326d\Downloads\PCB_v3.6\PCB_v3.6\Extruded_15_2.ipt
- C:\Users\8326d\Downloads\PCB_v3.6\PCB_v3.6\Extruded_8_3.ipt
- C:\Users\8326d\Downloads\PCB_v3.6\PCB_v3.6\Extruded_16_2.ipt
- C:\Users\8326d\Downloads\PCB_v3.6\PCB_v3.6\Extruded_17_2.ipt
- C:\Users\8326d\Downloads\PCB_v3.6\PCB_v3.6\Extruded_9_3.ipt
- C:\Users\8326d\Downloads\PCB_v3.6\PCB_v3.6\Extruded_18_2.ipt
- C:\Users\8326d\Downloads\PCB_v3.6\PCB_v3.6\Extruded_19_2.ipt
- C:\Users\8326d\Downloads\PCB_v3.6\PCB_v3.6\Extruded_10_2.ipt
- C:\Users\8326d\Downloads\PCB_v3.6\PCB_v3.6\Extruded_20_1.ipt
- C:\Users\8326d\Downloads\PCB_v3.6\PCB_v3.6\Extruded_21_1.ipt
- C:\Users\8326d\Downloads\PCB_v3.6\PCB_v3.6\Extruded_10_3.ipt
- C:\Users\8326d\Downloads\PCB_v3.6\PCB_v3.6\Extruded_20_2.ipt
- C:\Users\8326d\Downloads\PCB_v3.6\PCB_v3.6\Extruded_21_2.ipt
- C:\Users\8326d\Downloads\PCB_v3.6\PCB_v3.6\Extruded_11_2.ipt
- C:\Users\8326d\Downloads\PCB_v3.6\PCB_v3.6\Extruded_22.ipt
- C:\Users\8326d\Downloads\PCB_v3.6\PCB_v3.6\Extruded_23.ipt
- C:\Users\8326d\Downloads\PCB_v3.6\PCB_v3.6\Extruded_12_3.ipt
- C:\Users\8326d\Downloads\PCB_v3.6\PCB_v3.6\Extruded_24.ipt
- C:\Users\8326d\Downloads\PCB_v3.6\PCB_v3.6\Extruded_25.ipt
- C:\Users\8326d\Downloads\PCB_v3.6\PCB_v3.6\Extruded_26.ipt
- C:\Users\8326d\Downloads\PCB_v3.6\PCB_v3.6\Extruded_27.ipt
- C:\Users\8326d\Downloads\PCB_v3.6\PCB_v3.6\Extruded_1_9.ipt
- C:\Users\8326d\Downloads\PCB_v3.6\PCB_v3.6\Extruded_13_3.ipt
- C:\Users\8326d\Downloads\PCB_v3.6\PCB_v3.6\Extruded_26_1.ipt
- C:\Users\8326d\Downloads\PCB_v3.6\PCB_v3.6\Extruded_27_1.ipt
- C:\Users\8326d\Downloads\PCB_v3.6\PCB_v3.6\Extruded_14_3.ipt
- C:\Users\8326d\Downloads\PCB_v3.6\PCB_v3.6\Extruded_28.ipt
- C:\Users\8326d\Downloads\PCB_v3.6\PCB_v3.6\Extruded_29.ipt
- C:\Users\8326d\Downloads\PCB_v3.6\PCB_v3.6\Extruded_15_3.ipt
- C:\Users\8326d\Downloads\PCB_v3.6\PCB_v3.6\Extruded_30.ipt
- C:\Users\8326d\Downloads\PCB_v3.6\PCB_v3.6\Extruded_31.ipt
- C:\Users\8326d\Downloads\PCB_v3.6\PCB_v3.6\Extruded_16_3.ipt
- C:\Users\8326d\Downloads\PCB_v3.6\PCB_v3.6\Extruded_32.ipt
- C:\Users\8326d\Downloads\PCB_v3.6\PCB_v3.6\Extruded_33.ipt
- C:\Users\8326d\Downloads\PCB_v3.6\PCB_v3.6\Extruded_11_3.ipt
- C:\Users\8326d\Downloads\PCB_v3.6\PCB_v3.6\Extruded_22_1.ipt
- C:\Users\8326d\Downloads\PCB_v3.6\PCB_v3.6\Extruded_23_1.ipt
- C:\Users\8326d\Downloads\PCB_v3.6\PCB_v3.6\Extruded_17_3.ipt
- C:\Users\8326d\Downloads\PCB_v3.6\PCB_v3.6\Extruded_34.ipt
- C:\Users\8326d\Downloads\PCB_v3.6\PCB_v3.6\Extruded_35.ipt
- C:\Users\8326d\Downloads\PCB_v3.6\PCB_v3.6\Extruded_2_6.ipt
- C:\Users\8326d\Downloads\PCB_v3.6\PCB_v3.6\Extruded_3_6.ipt
- C:\Users\8326d\Downloads\PCB_v3.6\PCB_v3.6\Extruded_1_10.ipt
- C:\Users\8326d\Downloads\PCB_v3.6\PCB_v3.6\Extruded_4_5.ipt
- C:\Users\8326d\Downloads\PCB_v3.6\PCB_v3.6\Extruded_5_4.ipt
- C:\Users\8326d\Downloads\PCB_v3.6\PCB_v3.6\Extruded_2_7.ipt
- C:\Users\8326d\Downloads\PCB_v3.6\PCB_v3.6\CAP_Alum_Elec_Size_G.ipt
- C:\Users\8326d\Downloads\PCB_v3.6\PCB_v3.6\CAP_Alum_Elec_Size_G_1.ipt
- C:\Users\8326d\Downloads\PCB_v3.6\PCB_v3.6\CAP_Alum_Elec_Size_G_2.ipt
- C:\Users\8326d\Downloads\PCB_v3.6\PCB_v3.6\CAP_Alum_Elec_Size_G_3.ipt
- C:\Users\8326d\Downloads\PCB_v3.6\PCB_v3.6\CAP_Alum_Elec_Size_G_4.ipt
- C:\Users\8326d\Downloads\PCB_v3.6\PCB_v3.6\Extruded_12_4.ipt
- C:\Users\8326d\Downloads\PCB_v3.6\PCB_v3.6\Extruded_24_1.ipt
- C:\Users\8326d\Downloads\PCB_v3.6\PCB_v3.6\Extruded_25_1.ipt
- C:\Users\8326d\Downloads\PCB_v3.6\PCB_v3.6\Extruded_13_4.ipt
- C:\Users\8326d\Downloads\PCB_v3.6\PCB_v3.6\Extruded_26_2.ipt
- C:\Users\8326d\Downloads\PCB_v3.6\PCB_v3.6\Extruded_27_2.ipt
- C:\Users\8326d\Downloads\PCB_v3.6\PCB_v3.6\Extruded_14_4.ipt
- C:\Users\8326d\Downloads\PCB_v3.6\PCB_v3.6\Extruded_28_1.ipt
- C:\Users\8326d\Downloads\PCB_v3.6\PCB_v3.6\Extruded_29_1.ipt
- C:\Users\8326d\Downloads\PCB_v3.6\PCB_v3.6\Extruded_15_4.ipt
- C:\Users\8326d\Downloads\PCB_v3.6\PCB_v3.6\Extruded_30_1.ipt
- C:\Users\8326d\Downloads\PCB_v3.6\PCB_v3.6\Extruded_31_1.ipt
- C:\Users\8326d\Downloads\PCB_v3.6\PCB_v3.6\Extruded_16_4.ipt
- C:\Users\8326d\Downloads\PCB_v3.6\PCB_v3.6\Extruded_32_1.ipt
- C:\Users\8326d\Downloads\PCB_v3.6\PCB_v3.6\Extruded_33_1.ipt
- C:\Users\8326d\Downloads\PCB_v3.6\PCB_v3.6\Extruded_17_4.ipt
- C:\Users\8326d\Downloads\PCB_v3.6\PCB_v3.6\Extruded_34_1.ipt
- C:\Users\8326d\Downloads\PCB_v3.6\PCB_v3.6\Extruded_35_1.ipt
- C:\Users\8326d\Downloads\PCB_v3.6\PCB_v3.6\Extruded_18_3.ipt
- C:\Users\8326d\Downloads\PCB_v3.6\PCB_v3.6\Extruded_36.ipt
- C:\Users\8326d\Downloads\PCB_v3.6\PCB_v3.6\Extruded_37.ipt
- C:\Users\8326d\Downloads\PCB_v3.6\PCB_v3.6\Extruded_19_3.ipt
- C:\Users\8326d\Downloads\PCB_v3.6\PCB_v3.6\Extruded_38.ipt
- C:\Users\8326d\Downloads\PCB_v3.6\PCB_v3.6\Extruded_39.ipt
- C:\Users\8326d\Downloads\PCB_v3.6\PCB_v3.6\Extruded_20_3.ipt
- C:\Users\8326d\Downloads\PCB_v3.6\PCB_v3.6\Extruded_40.ipt
- C:\Users\8326d\Downloads\PCB_v3.6\PCB_v3.6\Extruded_41.ipt
- C:\Users\8326d\Downloads\PCB_v3.6\PCB_v3.6\Extruded_21_3.ipt
- C:\Users\8326d\Downloads\PCB_v3.6\PCB_v3.6\Extruded_42.ipt
- C:\Users\8326d\Downloads\PCB_v3.6\PCB_v3.6\Extruded_43.ipt
- C:\Users\8326d\Downloads\PCB_v3.6\PCB_v3.6\Extruded_22_2.ipt
- C:\Users\8326d\Downloads\PCB_v3.6\PCB_v3.6\Extruded_44.ipt
- C:\Users\8326d\Downloads\PCB_v3.6\PCB_v3.6\Extruded_45.ipt
- C:\Users\8326d\Downloads\PCB_v3.6\PCB_v3.6\CAP_Alum_Elec_Size_G_5.ipt
- C:\Users\8326d\Downloads\PCB_v3.6\PCB_v3.6\CAP_Alum_Elec_Size_G_6.ipt
- C:\Users\8326d\Downloads\PCB_v3.6\PCB_v3.6\CAP_Alum_Elec_Size_G_7.ipt
- C:\Users\8326d\Downloads\PCB_v3.6\PCB_v3.6\CAPC3216X175N_-_1206_(3216_metric)_3.ipt
- C:\Users\8326d\Downloads\PCB_v3.6\PCB_v3.6\Extruded_18_4.ipt
- C:\Users\8326d\Downloads\PCB_v3.6\PCB_v3.6\Extruded_36_1.ipt
- C:\Users\8326d\Downloads\PCB_v3.6\PCB_v3.6\Extruded_37_1.ipt
- C:\Users\8326d\Downloads\PCB_v3.6\PCB_v3.6\Extruded_19_4.ipt
- C:\Users\8326d\Downloads\PCB_v3.6\PCB_v3.6\Extruded_38_1.ipt
- C:\Users\8326d\Downloads\PCB_v3.6\PCB_v3.6\Extruded_39_1.ipt
- C:\Users\8326d\Downloads\PCB_v3.6\PCB_v3.6\Extruded_23_2.ipt
- C:\Users\8326d\Downloads\PCB_v3.6\PCB_v3.6\Extruded_46.ipt
- C:\Users\8326d\Downloads\PCB_v3.6\PCB_v3.6\Extruded_47.ipt
- C:\Users\8326d\Downloads\PCB_v3.6\PCB_v3.6\Extruded_20_4.ipt
- C:\Users\8326d\Downloads\PCB_v3.6\PCB_v3.6\Extruded_40_1.ipt
- C:\Users\8326d\Downloads\PCB_v3.6\PCB_v3.6\Extruded_41_1.ipt
- C:\Users\8326d\Downloads\PCB_v3.6\PCB_v3.6\Extruded_21_4.ipt
- C:\Users\8326d\Downloads\PCB_v3.6\PCB_v3.6\Extruded_42_1.ipt
- C:\Users\8326d\Downloads\PCB_v3.6\PCB_v3.6\Extruded_43_1.ipt
- C:\Users\8326d\Downloads\PCB_v3.6\PCB_v3.6\Extruded_22_3.ipt
- C:\Users\8326d\Downloads\PCB_v3.6\PCB_v3.6\Extruded_44_1.ipt
- C:\Users\8326d\Downloads\PCB_v3.6\PCB_v3.6\Extruded_45_1.ipt
- C:\Users\8326d\Downloads\PCB_v3.6\PCB_v3.6\Extruded_23_3.ipt
- C:\Users\8326d\Downloads\PCB_v3.6\PCB_v3.6\Extruded_46_1.ipt
- C:\Users\8326d\Downloads\PCB_v3.6\PCB_v3.6\Extruded_47_1.ipt
- C:\Users\8326d\Downloads\PCB_v3.6\PCB_v3.6\CAPC3216X175N_-_1206_(3216_metric)_4.ipt
- C:\Users\8326d\Downloads\PCB_v3.6\PCB_v3.6\Extruded_24_2.ipt
- C:\Users\8326d\Downloads\PCB_v3.6\PCB_v3.6\Extruded_48.ipt
- C:\Users\8326d\Downloads\PCB_v3.6\PCB_v3.6\Extruded_49.ipt
- C:\Users\8326d\Downloads\PCB_v3.6\PCB_v3.6\Extruded_25_2.ipt
- C:\Users\8326d\Downloads\PCB_v3.6\PCB_v3.6\Extruded_50.ipt
- C:\Users\8326d\Downloads\PCB_v3.6\PCB_v3.6\Extruded_51.ipt
- C:\Users\8326d\Downloads\PCB_v3.6\PCB_v3.6\User_Library-DFN5x6_SO8FL_Extruded_32.ipt
- C:\Users\8326d\Downloads\PCB_v3.6\PCB_v3.6\User_Library-DFN5x6_SO8FL_Extruded_2_32.ipt
- C:\Users\8326d\Downloads\PCB_v3.6\PCB_v3.6\User_Library-DFN5x6_SO8FL_Extruded_2_33.ipt
- C:\Users\8326d\Downloads\PCB_v3.6\PCB_v3.6\User_Library-DFN5x6_SO8FL_Extruded_33.ipt
- C:\Users\8326d\Downloads\PCB_v3.6\PCB_v3.6\User_Library-DFN5x6_SO8FL_Cylinder_16.ipt
- C:\Users\8326d\Downloads\PCB_v3.6\PCB_v3.6\User_Library-DFN5x6_SO8FL_Extruded_3_16.ipt
- C:\Users\8326d\Downloads\PCB_v3.6\PCB_v3.6\User_Library-DFN5x6_SO8FL_Extruded_4_16.ipt
- C:\Users\8326d\Downloads\PCB_v3.6\PCB_v3.6\User_Library-DFN5x6_SO8FL_Extruded_5_64.ipt
- C:\Users\8326d\Downloads\PCB_v3.6\PCB_v3.6\User_Library-DFN5x6_SO8FL_Extruded_5_65.ipt
- C:\Users\8326d\Downloads\PCB_v3.6\PCB_v3.6\User_Library-DFN5x6_SO8FL_Extruded_5_66.ipt
- C:\Users\8326d\Downloads\PCB_v3.6\PCB_v3.6\User_Library-DFN5x6_SO8FL_Extruded_5_67.ipt
- C:\Users\8326d\Downloads\PCB_v3.6\PCB_v3.6\User_Library-DFN5x6_SO8FL_Extruded_6_16.ipt
- C:\Users\8326d\Downloads\PCB_v3.6\PCB_v3.6\User_Library-DFN5x6_SO8FL_Extruded_34.ipt
- C:\Users\8326d\Downloads\PCB_v3.6\PCB_v3.6\User_Library-DFN5x6_SO8FL_Extruded_2_34.ipt
- C:\Users\8326d\Downloads\PCB_v3.6\PCB_v3.6\User_Library-DFN5x6_SO8FL_Extruded_2_35.ipt
- C:\Users\8326d\Downloads\PCB_v3.6\PCB_v3.6\User_Library-DFN5x6_SO8FL_Extruded_35.ipt
- C:\Users\8326d\Downloads\PCB_v3.6\PCB_v3.6\User_Library-DFN5x6_SO8FL_Cylinder_17.ipt
- C:\Users\8326d\Downloads\PCB_v3.6\PCB_v3.6\User_Library-DFN5x6_SO8FL_Extruded_3_17.ipt
- C:\Users\8326d\Downloads\PCB_v3.6\PCB_v3.6\User_Library-DFN5x6_SO8FL_Extruded_4_17.ipt
- C:\Users\8326d\Downloads\PCB_v3.6\PCB_v3.6\User_Library-DFN5x6_SO8FL_Extruded_5_68.ipt
- C:\Users\8326d\Downloads\PCB_v3.6\PCB_v3.6\User_Library-DFN5x6_SO8FL_Extruded_5_69.ipt
- C:\Users\8326d\Downloads\PCB_v3.6\PCB_v3.6\User_Library-DFN5x6_SO8FL_Extruded_5_70.ipt
- C:\Users\8326d\Downloads\PCB_v3.6\PCB_v3.6\User_Library-DFN5x6_SO8FL_Extruded_5_71.ipt
- C:\Users\8326d\Downloads\PCB_v3.6\PCB_v3.6\User_Library-DFN5x6_SO8FL_Extruded_6_17.ipt
- C:\Users\8326d\Downloads\PCB_v3.6\PCB_v3.6\User_Library-DFN5x6_SO8FL_Extruded_36.ipt
- C:\Users\8326d\Downloads\PCB_v3.6\PCB_v3.6\User_Library-DFN5x6_SO8FL_Extruded_2_36.ipt
- C:\Users\8326d\Downloads\PCB_v3.6\PCB_v3.6\User_Library-DFN5x6_SO8FL_Extruded_2_37.ipt
- C:\Users\8326d\Downloads\PCB_v3.6\PCB_v3.6\User_Library-DFN5x6_SO8FL_Extruded_37.ipt
- C:\Users\8326d\Downloads\PCB_v3.6\PCB_v3.6\User_Library-DFN5x6_SO8FL_Cylinder_18.ipt
- C:\Users\8326d\Downloads\PCB_v3.6\PCB_v3.6\User_Library-DFN5x6_SO8FL_Extruded_3_18.ipt
- C:\Users\8326d\Downloads\PCB_v3.6\PCB_v3.6\User_Library-DFN5x6_SO8FL_Extruded_4_18.ipt
- C:\Users\8326d\Downloads\PCB_v3.6\PCB_v3.6\User_Library-DFN5x6_SO8FL_Extruded_5_72.ipt
- C:\Users\8326d\Downloads\PCB_v3.6\PCB_v3.6\User_Library-DFN5x6_SO8FL_Extruded_5_73.ipt
- C:\Users\8326d\Downloads\PCB_v3.6\PCB_v3.6\User_Library-DFN5x6_SO8FL_Extruded_5_74.ipt
- C:\Users\8326d\Downloads\PCB_v3.6\PCB_v3.6\User_Library-DFN5x6_SO8FL_Extruded_5_75.ipt
- C:\Users\8326d\Downloads\PCB_v3.6\PCB_v3.6\User_Library-DFN5x6_SO8FL_Extruded_6_18.ipt
- C:\Users\8326d\Downloads\PCB_v3.6\PCB_v3.6\User_Library-DFN5x6_SO8FL_Extruded_38.ipt
- C:\Users\8326d\Downloads\PCB_v3.6\PCB_v3.6\User_Library-DFN5x6_SO8FL_Extruded_2_38.ipt
- C:\Users\8326d\Downloads\PCB_v3.6\PCB_v3.6\User_Library-DFN5x6_SO8FL_Extruded_2_39.ipt
- C:\Users\8326d\Downloads\PCB_v3.6\PCB_v3.6\User_Library-DFN5x6_SO8FL_Extruded_39.ipt
- C:\Users\8326d\Downloads\PCB_v3.6\PCB_v3.6\User_Library-DFN5x6_SO8FL_Cylinder_19.ipt
- C:\Users\8326d\Downloads\PCB_v3.6\PCB_v3.6\User_Library-DFN5x6_SO8FL_Extruded_3_19.ipt
- C:\Users\8326d\Downloads\PCB_v3.6\PCB_v3.6\User_Library-DFN5x6_SO8FL_Extruded_4_19.ipt
- C:\Users\8326d\Downloads\PCB_v3.6\PCB_v3.6\User_Library-DFN5x6_SO8FL_Extruded_5_76.ipt
- C:\Users\8326d\Downloads\PCB_v3.6\PCB_v3.6\User_Library-DFN5x6_SO8FL_Extruded_5_77.ipt
- C:\Users\8326d\Downloads\PCB_v3.6\PCB_v3.6\User_Library-DFN5x6_SO8FL_Extruded_5_78.ipt
- C:\Users\8326d\Downloads\PCB_v3.6\PCB_v3.6\User_Library-DFN5x6_SO8FL_Extruded_5_79.ipt
- C:\Users\8326d\Downloads\PCB_v3.6\PCB_v3.6\User_Library-DFN5x6_SO8FL_Extruded_6_19.ipt
- C:\Users\8326d\Downloads\PCB_v3.6\PCB_v3.6\User_Library-DFN5x6_SO8FL_Extruded_40.ipt
- C:\Users\8326d\Downloads\PCB_v3.6\PCB_v3.6\User_Library-DFN5x6_SO8FL_Extruded_2_40.ipt
- C:\Users\8326d\Downloads\PCB_v3.6\PCB_v3.6\User_Library-DFN5x6_SO8FL_Extruded_2_41.ipt
- C:\Users\8326d\Downloads\PCB_v3.6\PCB_v3.6\User_Library-DFN5x6_SO8FL_Extruded_41.ipt
- C:\Users\8326d\Downloads\PCB_v3.6\PCB_v3.6\User_Library-DFN5x6_SO8FL_Cylinder_20.ipt